# Autodesk Inventor assembly: robotfish_new_1
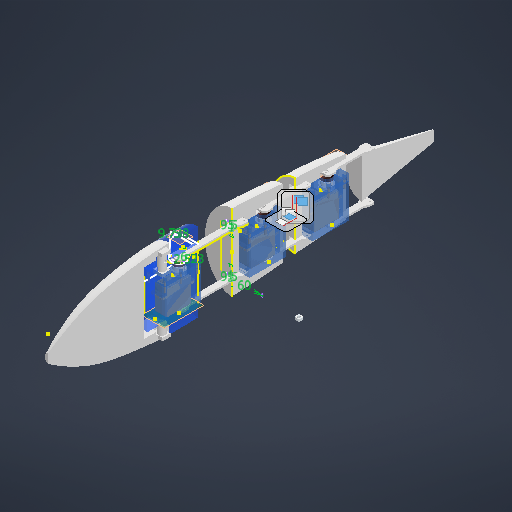
[picture p0: Inventor's stored thumbnail of the model, 512x512]
Saved by Autodesk Inventor 2027 (Build 310192060, 192F)
## iProperties
Created: 2026-08-14
Part Number: robotfish_new_1
Document SubType Name: Assembly
Designer: thita
Author: thita
## Documents named in this file (17)
- D:\Year2\đồ án tốt nghịp\đồ án tốt nghiệp v2\mới nhất\robotfish_new\Workgroups\NotInProject\robotfish_new_1.iam
- D:\Year2\đồ án tốt nghịp\đồ án tốt nghiệp v2\mới nhất\robotfish_new\Workgroups\NotInProject\tail.ipt
- D:\Year2\đồ án tốt nghịp\đồ án tốt nghiệp v2\mới nhất\robotfish_new\Workgroups\NotInProject\segment2.ipt
- D:\Year2\đồ án tốt nghịp\đồ án tốt nghiệp v2\mới nhất\robotfish_new\Workgroups\NotInProject\segment3.ipt
- D:\Year2\đồ án tốt nghịp\đồ án tốt nghiệp v2\mới nhất\robotfish_new\Workgroups\NotInProject\thanh lk.ipt
- D:\Year2\đồ án tốt nghịp\đồ án tốt nghiệp v2\mới nhất\robotfish_new\Workgroups\NotInProject\thanh lk 1.ipt
- D:\Year2\đồ án tốt nghịp\đồ án tốt nghiệp v2\mới nhất\robotfish_new\Workgroups\NotInProject\manh_tren_truc_2.ipt
- D:\Year2\đồ án tốt nghịp\đồ án tốt nghiệp v2\mới nhất\robotfish_new\Workgroups\NotInProject\manh_tren_truc_3.ipt
- D:\Year2\đồ án tốt nghịp\đồ án tốt nghiệp v2\mới nhất\robotfish_new\Workgroups\NotInProject\segment1.ipt
- D:\Year2\đồ án tốt nghịp\đồ án tốt nghiệp v2\mới nhất\robotfish_new\Workgroups\NotInProject\head.ipt
- D:\Year2\đồ án tốt nghịp\đồ án tốt nghiệp v2\mới nhất\robotfish_new\Workgroups\NotInProject\truc_khop_3_MIR.ipt
- D:\Year2\đồ án tốt nghịp\đồ án tốt nghiệp v2\mới nhất\robotfish_new\Workgroups\NotInProject\Bearing 684-2Z (STEP AP214).ipt
- D:\Year2\đồ án tốt nghịp\đồ án tốt nghiệp v2\mới nhất\robotfish_new\Workgroups\NotInProject\thanhlk 3.ipt
- D:\Year2\đồ án tốt nghịp\đồ án tốt nghiệp v2\mới nhất\robotfish_new\Workgroups\NotInProject\hop v3.iam
- D:\Year2\đồ án tốt nghịp\đồ án tốt nghiệp v2\mới nhất\robotfish_new\Workgroups\NotInProject\thanh lk 4.ipt
- D:\Year2\đồ án tốt nghịp\đồ án tốt nghiệp v2\mới nhất\robotfish_new\Workgroups\NotInProject\thanhlk 5.ipt
- D:\Year2\đồ án tốt nghịp\đồ án tốt nghiệp v2\hộp v5\Workgroups\NotInProject\Assembly1.iam
## Components (19 placed, 16 different names)
1. segment2:1 — Mate:1, Mate:2
2. segment3:1 — Mate:11
3. thanh lk:1 — Mate:8, Mate:9, Mate:10
4. thanh lk 1:1 — Flush:2, Mate:16, Mate:17
5. tail:1
6. manh_tren_truc_2:1 — Rigid:6
7. manh_tren_truc_3:1 — Rigid:6, Rigid:8
8. segment1:1 — Mate:5, Mate:6, Mate:7, Flush:1
9. head:1 — Rigid:8, Rigid:9
10. truc_khop_3_MIR:1 — Rigid:9
11. Bearing 684-2Z (STEP AP214):1 — Rotational:4
12. Bearing 684-2Z (STEP AP214):2
13. thanhlk 3:1 — Rotational:4
14. hop v3:13 [sub-assembly] — Mate:1, Mate:2, Mate:8, Mate:9, Flush:2, Mate:16, Mate:17
15. hop v3:14 [sub-assembly] — Mate:11, Mate:13, Mate:14
16. thanh lk 4:1
17. thanhlk 5:1
18. Assembly1:17 [sub-assembly] — Mate:5, Mate:6, Mate:7, Mate:10, Flush:1
19. thanh lk 1:2 — Mate:13, Mate:14
## Relationships (19: Mate 13, WeldJoint 3, Flush 2, RevoluteJoint 1)
- Rigid:6 [WeldJoint]: manh_tren_truc_2:1 ↔ manh_tren_truc_3:1
- Rigid:8 [WeldJoint]: manh_tren_truc_3:1 ↔ head:1
- Rigid:9 [WeldJoint]: head:1 ↔ truc_khop_3_MIR:1
- Mate:1: segment2:1 ↔ hop v3:13
- Mate:2: segment2:1 ↔ hop v3:13
- Rotational:4 [RevoluteJoint]: Bearing 684-2Z (STEP AP214):1 ↔ thanhlk 3:1
- Mate:5: segment1:1 ↔ Assembly1:17
- Mate:6: segment1:1 ↔ Assembly1:17
- Mate:7: segment1:1 ↔ Assembly1:17
- Mate:8: thanh lk:1 ↔ hop v3:13
- Mate:9: thanh lk:1 ↔ hop v3:13
- Mate:10: thanh lk:1 ↔ Assembly1:17
- Flush:1: segment1:1 ↔ Assembly1:17
- Mate:11: segment3:1 ↔ hop v3:14
- Mate:13: hop v3:14 ↔ thanh lk 1:2
- Mate:14: hop v3:14 ↔ thanh lk 1:2
- Flush:2 (-0.04 mm): thanh lk 1:1 ↔ hop v3:13
- Mate:16 (0.04 mm): thanh lk 1:1 ↔ hop v3:13
- Mate:17 (0.04 mm): thanh lk 1:1 ↔ hop v3:13
## Named parameters: Finish1_Area = 400.632, Finish2_Area = 400.632, Finish3_Area = 400.632
note: some values were not read from the file. Shown as the stored number, unit unknown: "Finish1_Area", "Finish2_Area", "Finish3_Area".
